# Autodesk Inventor assembly: общая сборка
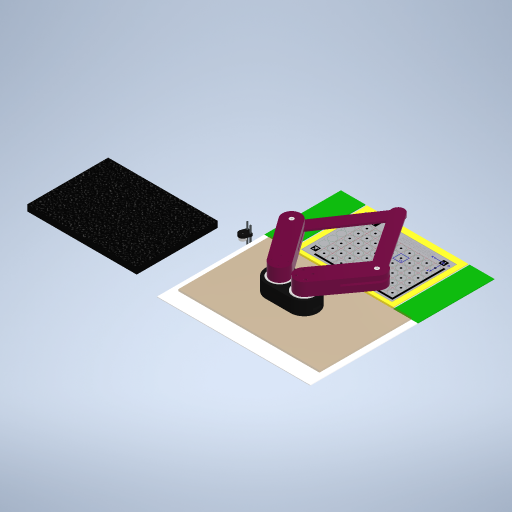
[picture p0: Inventor's stored thumbnail of the model, 512x512]
Saved by Autodesk Inventor 2024.2 (Build 282272000, 272)
## iProperties
Created: 2026-10-08
Part Number: общая сборка
Document SubType Name: Assembly
Designer: User
Author: User
## Documents named in this file (4)
- D:\alletz2\ETZ_10\construction\общая сборка.iam
- D:\alletz2\ETZ_10\construction\робот\robot.iam
- D:\alletz2\ETZ_10\construction\полигон\полигон.iam
- D:\alletz2\ETZ_10\construction\ноутбук.ipt
## Components (3 placed, 3 different names)
1. robot:1 [sub-assembly] — Совмещение:1, Заподлицо:2, Совмещение:2
2. полигон:1 [sub-assembly] — Совмещение:1, Заподлицо:1, Заподлицо:2, Совмещение:2
3. ноутбук:1 — Заподлицо:1
## Relationships (4: Mate 2, Flush 2)
- Совмещение:1 [Mate]: robot:1 ↔ полигон:1
- Заподлицо:1 [Flush]: полигон:1 ↔ ноутбук:1
- Заподлицо:2 [Flush] (-20 mm): robot:1 ↔ полигон:1
- Совмещение:2 [Mate]: robot:1 ↔ полигон:1
